# Autodesk Inventor assembly: Assembly1
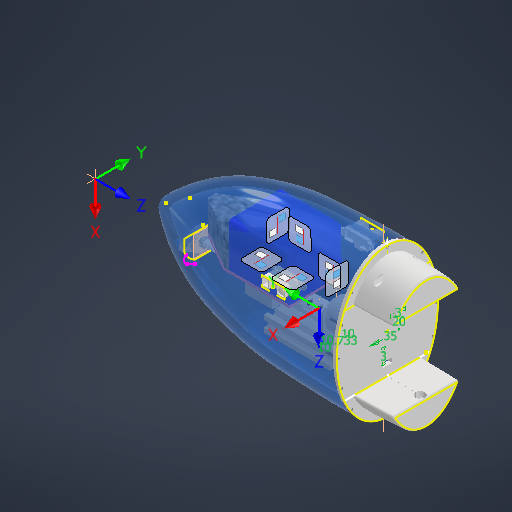
[picture p0: Inventor's stored thumbnail of the model, 512x512]
Saved by Autodesk Inventor 2027 (Build 310192060, 192F)
## iProperties
Created: 2026-06-12
Part Number: Assembly1
Document SubType Name: Assembly
Designer: thita
Author: thita
## Documents named in this file (15)
- D:\Year2\đồ án tốt nghịp\new fish\New folder\Workgroups\NotInProject\Assembly1.iam
- D:\Year2\đồ án tốt nghịp\new fish\New folder\Workgroups\NotInProject\DESIGN\Workgroups\NotInProject\NotInProject\DAU.ipt
- D:\Year2\đồ án tốt nghịp\new fish\New folder\Workgroups\NotInProject\GP2Y0A02YK0F SHARP.ipt
- D:\Year2\đồ án tốt nghịp\new fish\New folder\Workgroups\NotInProject\Khối pin sạc Li-ion 12V 21Ah 30A 3S MTM.ipt
- D:\Year2\đồ án tốt nghịp\new fish\New folder\Workgroups\NotInProject\DESIGN\Workgroups\NotInProject\NotInProject\NAP.ipt
- D:\Year2\đồ án tốt nghịp\new fish\New folder\Workgroups\NotInProject\Step - Nema 17 - 17HS4401S - Usongshine.ipt
- D:\Year2\đồ án tốt nghịp\new fish\New folder\Workgroups\NotInProject\2040ALUMINIUM PROFIL 35CM_MIR.ipt
- D:\Year2\đồ án tốt nghịp\new fish\New folder\Workgroups\NotInProject\Gia_truc_z.ipt
- D:\Year2\đồ án tốt nghịp\new fish\New folder\Workgroups\NotInProject\5mm to 8mm rigid shaft coupler v2.ipt
- D:\Year2\đồ án tốt nghịp\new fish\New folder\Workgroups\NotInProject\vitme-t8-buoc2.ipt
- D:\Year2\đồ án tốt nghịp\new fish\New folder\Workgroups\NotInProject\Goi Do Dai Oc.ipt
- D:\Year2\đồ án tốt nghịp\new fish\New folder\Workgroups\NotInProject\JGB37-520.ipt
- D:\Year2\đồ án tốt nghịp\new fish\New folder\Workgroups\NotInProject\KFL08.ipt
- D:\Year2\đồ án tốt nghịp\new fish\new new new new\Workgroups\NotInProject\MIENG SAT DE DO.ipt
- D:\Year2\đồ án tốt nghịp\new fish\new new new new\Workgroups\NotInProject\Ta bang inox.ipt
## Components (15 placed, 14 different names)
1. DAU:1 — Mate:4, Mate:5, Mate:6, Mate:7, Flush:1, Mate:27, Rotational:3, Flush:2, Flush:4
2. GP2Y0A02YK0F SHARP:1 — Mate:6, Mate:7
3. GP2Y0A02YK0F SHARP:2 — Mate:4, Mate:5
4. Khối pin sạc Li-ion 12V 21Ah 30A 3S MTM:1 — Mate:29, Flush:5, Mate:30
5. NAP:1 — Rotational:3
6. 2040ALUMINIUM PROFIL 35CM_MIR:1 — Mate:23, Mate:26, Rigid:9, Flush:2
7. Step - Nema 17 - 17HS4401S - Usongshine:2 — Rigid:6, Rotational:2, Flush:1
8. Goi Do Dai Oc:1 — Mate:26, Mate:28, Flush:6
9. Gia_truc_z:1 — Rigid:6, Mate:23, Rigid:9
10. 5mm to 8mm rigid shaft coupler v2:1 — Rotational:2, Rigid:7, Rigid:8
11. vitme-t8-buoc2:1 — Rigid:7, Mate:28, Rigid:10
12. JGB37-520:1 — Rigid:8, Mate:27
13. KFL08:1 — Rigid:10, Flush:4
14. MIENG SAT DE DO:1 — Mate:29, Flush:5, Flush:6, Mate:31, Flush:7
15. Ta bang inox:1 — Mate:30, Mate:31, Flush:7
## Relationships (24: Mate 11, Flush 6, WeldJoint 5, RevoluteJoint 2)
- Mate:4: DAU:1 ↔ GP2Y0A02YK0F SHARP:2
- Mate:5: DAU:1 ↔ GP2Y0A02YK0F SHARP:2
- Mate:6: DAU:1 ↔ GP2Y0A02YK0F SHARP:1
- Mate:7: DAU:1 ↔ GP2Y0A02YK0F SHARP:1
- Rigid:6 [WeldJoint]: Step - Nema 17 - 17HS4401S - Usongshine:2 ↔ Gia_truc_z:1
- Rotational:2 [RevoluteJoint] (-10 mm): Step - Nema 17 - 17HS4401S - Usongshine:2 ↔ 5mm to 8mm rigid shaft coupler v2:1
- Rigid:7 [WeldJoint] (-5 mm): 5mm to 8mm rigid shaft coupler v2:1 ↔ vitme-t8-buoc2:1
- Mate:23: 2040ALUMINIUM PROFIL 35CM_MIR:1 ↔ Gia_truc_z:1
- Flush:1: DAU:1 ↔ Step - Nema 17 - 17HS4401S - Usongshine:2
- Mate:26 (9.328 mm): 2040ALUMINIUM PROFIL 35CM_MIR:1 ↔ Goi Do Dai Oc:1
- Rigid:8 [WeldJoint]: 5mm to 8mm rigid shaft coupler v2:1 ↔ JGB37-520:1
- Mate:27: DAU:1 ↔ JGB37-520:1
- Rotational:3 [RevoluteJoint]: DAU:1 ↔ NAP:1
- Rigid:9 [WeldJoint]: 2040ALUMINIUM PROFIL 35CM_MIR:1 ↔ Gia_truc_z:1
- Mate:28: Goi Do Dai Oc:1 ↔ vitme-t8-buoc2:1
- Flush:2: DAU:1 ↔ 2040ALUMINIUM PROFIL 35CM_MIR:1
- Rigid:10 [WeldJoint] (-6 mm): vitme-t8-buoc2:1 ↔ KFL08:1
- Flush:4: DAU:1 ↔ KFL08:1
- Mate:29: Khối pin sạc Li-ion 12V 21Ah 30A 3S MTM:1 ↔ MIENG SAT DE DO:1
- Flush:5: Khối pin sạc Li-ion 12V 21Ah 30A 3S MTM:1 ↔ MIENG SAT DE DO:1
- Flush:6 (-15 mm): Goi Do Dai Oc:1 ↔ MIENG SAT DE DO:1
- Mate:30 (1.5 mm): Khối pin sạc Li-ion 12V 21Ah 30A 3S MTM:1 ↔ Ta bang inox:1
- Mate:31: MIENG SAT DE DO:1 ↔ Ta bang inox:1
- Flush:7 (-0.3 mm): MIENG SAT DE DO:1 ↔ Ta bang inox:1
## Named parameters: Finish2_Area = 9.80067, Finish3_Area = 16.8006, Finish4_Area = 23.3278, Finish5_Area = 23.3278, Finish6_Area = 1.06717
note: some values were not read from the file. Shown as the stored number, unit unknown: "Finish2_Area", "Finish3_Area", "Finish4_Area", "Finish5_Area", "Finish6_Area".
